# Autodesk Inventor assembly: Montagem
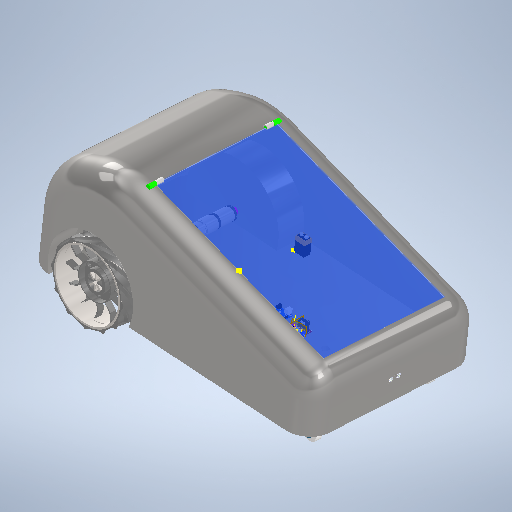
[picture p0: Inventor's stored thumbnail of the model, 512x512]
Saved by Autodesk Inventor 2025.1 (Build 291241020, 241B)
## iProperties
Created: 2024-11-02
Part Number: Montagem
Document SubType Name: Assembly
Designer: Alecs
Author: Alecs
## Documents named in this file (13)
- C:\Users\Lenovo\Downloads\Peças robo real\Montagem (1).iam
- C:\Users\Lenovo\Downloads\Peças robo real\Chassi (1).ipt
- C:\Users\Lenovo\Downloads\Peças robo real\Bucha.ipt
- C:\Users\Lenovo\Downloads\Peças robo real\roda real.ipt
- C:\Users\Lenovo\Downloads\Peças robo real\RMCS-2081.ipt
- C:\Users\Lenovo\Downloads\Peças robo real\rodizio robo real.iam
- C:\Users\Lenovo\Downloads\Peças robo real\Tampa.ipt
- C:\Users\Lenovo\Downloads\Peças robo real\Gonzo Macho.ipt
- C:\Users\Lenovo\Downloads\Peças robo real\Gonzo femea.ipt
- C:\Users\Lenovo\Downloads\SENSORultimo\SENSORultimo\SENSORultimo.ipt
- C:\Users\Lenovo\Downloads\Peça1.ipt,PILHA 9V arthur.ipt2.ipt 01.ipt
- C:\Users\Lenovo\Downloads\Componentes elétricos\Arduino UNO R3.ipt
- C:\Users\Lenovo\Downloads\Componentes elétricos\H-brug.ipt
## Components (20 placed, 12 different names)
1. Chassi (1):1 — Coincidente:7, Coincidente:8, Alinhado:1, Coincidente:11, Alinhado:2, Coincidente:15, Coincidente:23, Coincidente:24, Coincidente:25, Coincidente:26, Coincidente:27, Coincidente:28, Coincidente:29, Inserir:1, Inserir:2, Inserir:3, Coincidente:34, Coincidente:35, Coincidente:36, Coincidente:37, Coincidente:38, Coincidente:39, Coincidente:40, Coincidente:41
2. roda real:1 — Coincidente:7, Coincidente:14
3. roda real:2 — Coincidente:15, Coincidente:16
4. Bucha:2 — Coincidente:8, Alinhado:1, Coincidente:14, Coincidente:19, Coincidente:20
5. Bucha:3 — Coincidente:11, Alinhado:2, Coincidente:16, Coincidente:17, Coincidente:18
6. RMCS-2081:1 — Coincidente:17, Coincidente:18
7. RMCS-2081:2 — Coincidente:19, Coincidente:20
8. rodizio robo real:1 [sub-assembly] — Coincidente:23, Coincidente:24, Alinhado:3
9. rodizio robo real:2 [sub-assembly] — Alinhado:3, Coincidente:25, Coincidente:39, Coincidente:40, Coincidente:41
10. Tampa:1 — Coincidente:26, Coincidente:27, Coincidente:28, Coincidente:29, Rígida:1, Rígida:2
11. Gonzo Macho:1 — Coincidente:30, Coincidente:31, Rígida:1
12. Gonzo Macho:3 — Coincidente:32, Coincidente:33, Rígida:2
13. Gonzo femea:1 — Coincidente:30, Coincidente:31
14. Gonzo femea:2 — Coincidente:32, Coincidente:33
15. SENSORultimo:1 — Inserir:1, Inserir:2, Inserir:3
16. Peça1.ipt,PILHA 9V arthur.ipt2.ipt 01:1 — Coincidente:34
17. Peça1.ipt,PILHA 9V arthur.ipt2.ipt 01:2 — Coincidente:35
18. Arduino UNO R3:1 — Coincidente:36
19. H-brug:1 — Coincidente:37
20. H-brug:2 — Coincidente:38
## Relationships (37: Mate 29, Flush 3, Insert 3, WeldJoint 2)
- Coincidente:7 [Mate]: Chassi (1):1 ↔ roda real:1
- Coincidente:8 [Mate]: Chassi (1):1 ↔ Bucha:2
- Alinhado:1 [Flush]: Chassi (1):1 ↔ Bucha:2
- Coincidente:11 [Mate]: Chassi (1):1 ↔ Bucha:3
- Alinhado:2 [Flush]: Chassi (1):1 ↔ Bucha:3
- Coincidente:14 [Mate]: roda real:1 ↔ Bucha:2
- Coincidente:15 [Mate]: Chassi (1):1 ↔ roda real:2
- Coincidente:16 [Mate]: roda real:2 ↔ Bucha:3
- Coincidente:17 [Mate]: Bucha:3 ↔ RMCS-2081:1
- Coincidente:18 [Mate]: Bucha:3 ↔ RMCS-2081:1
- Coincidente:19 [Mate]: Bucha:2 ↔ RMCS-2081:2
- Coincidente:20 [Mate]: Bucha:2 ↔ RMCS-2081:2
- Coincidente:23 [Mate]: Chassi (1):1 ↔ rodizio robo real:1
- Coincidente:24 [Mate]: Chassi (1):1 ↔ rodizio robo real:1
- Alinhado:3 [Flush]: rodizio robo real:1 ↔ rodizio robo real:2
- Coincidente:25 [Mate]: Chassi (1):1 ↔ rodizio robo real:2
- Coincidente:26 [Mate]: Chassi (1):1 ↔ Tampa:1
- Coincidente:27 [Mate]: Chassi (1):1 ↔ Tampa:1
- Coincidente:28 [Mate]: Chassi (1):1 ↔ Tampa:1
- Coincidente:29 [Mate]: Chassi (1):1 ↔ Tampa:1
- Coincidente:30 [Mate]: Gonzo Macho:1 ↔ Gonzo femea:1
- Coincidente:31 [Mate]: Gonzo Macho:1 ↔ Gonzo femea:1
- Coincidente:32 [Mate]: Gonzo Macho:3 ↔ Gonzo femea:2
- Coincidente:33 [Mate]: Gonzo Macho:3 ↔ Gonzo femea:2
- Rígida:1 [WeldJoint]: Tampa:1 ↔ Gonzo Macho:1
- Rígida:2 [WeldJoint]: Tampa:1 ↔ Gonzo Macho:3
- Inserir:1: Chassi (1):1 ↔ SENSORultimo:1
- Inserir:2: Chassi (1):1 ↔ SENSORultimo:1
- Inserir:3: Chassi (1):1 ↔ SENSORultimo:1
- Coincidente:34 [Mate]: Chassi (1):1 ↔ Peça1.ipt,PILHA 9V arthur.ipt2.ipt 01:1
- Coincidente:35 [Mate]: Chassi (1):1 ↔ Peça1.ipt,PILHA 9V arthur.ipt2.ipt 01:2
- Coincidente:36 [Mate]: Chassi (1):1 ↔ Arduino UNO R3:1
- Coincidente:37 [Mate]: Chassi (1):1 ↔ H-brug:1
- Coincidente:38 [Mate]: Chassi (1):1 ↔ H-brug:2
- Coincidente:39 [Mate]: Chassi (1):1 ↔ rodizio robo real:2
- Coincidente:40 [Mate]: Chassi (1):1 ↔ rodizio robo real:2
- Coincidente:41 [Mate]: Chassi (1):1 ↔ rodizio robo real:2
## Named parameters: Finish1_Area = 5449.21, Finish2_Area = 5449.21
note: some values were not read from the file. Shown as the stored number, unit unknown: "Finish1_Area", "Finish2_Area".
